# Autodesk Inventor assembly: 20021-003_arm-clip
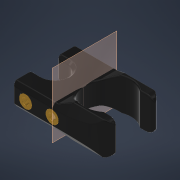
[picture p0: Inventor's stored thumbnail of the model, 180x180]
Saved by Autodesk Inventor 2021 (Build 250183000, 183)
## iProperties
Created: 2021-05-23
Part Number: 20021-003_arm-clip
Document SubType Name: Assembly
Designer: Administrator
Title: 20021-003_arm-clip v2
Author: Administrator
## Documents named in this file (3)
- D:\Experimen\Inventor\BAYUCARAKA\Tarot\Arm Clip\20021-003_arm-clip.iam
- D:\Experimen\Inventor\BAYUCARAKA\Tarot\Arm Clip\94180A321.ipt
- D:\Experimen\Inventor\BAYUCARAKA\Tarot\Arm Clip\20021-003_arm-clip v2.ipt
## Components (5 placed, 2 different names)
1. 94180A321:1 — Flush:2
2. 94180A321:2 — Flush:2, Mate:2
3. 94180A321:3 — Flush:1, Mate:1
4. 94180A321:4 — Flush:1
5. 20021-003_arm-clip v2 — Mate:1, Mate:2
## Relationships (4: Flush 2, Mate 2)
- Flush:1: 94180A321:3 ↔ 94180A321:4
- Mate:1: 94180A321:3 ↔ 20021-003_arm-clip v2
- Flush:2: 94180A321:1 ↔ 94180A321:2
- Mate:2: 94180A321:2 ↔ 20021-003_arm-clip v2
